# Autodesk Inventor assembly: robotfish_new_1
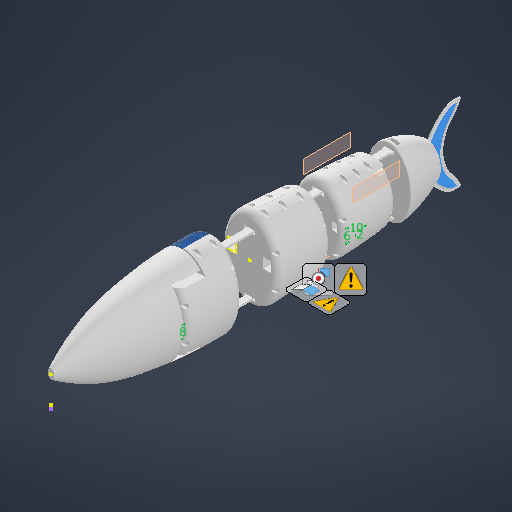
[picture p0: Inventor's stored thumbnail of the model, 512x512]
Saved by Autodesk Inventor 2027 (Build 310192060, 192F)
## iProperties
Created: 2026-08-24
Part Number: robotfish_new_1
Document SubType Name: Assembly
Designer: thita
Sending System: Autodesk Inventor 2027
Preprocessor: ST-DEVELOPER v20.1
Title: robotfish_newest_1.stp
Author: thita
## Documents named in this file (21)
- D:\Year2\đồ án tốt nghịp\đồ án tốt nghiệp v2\mới nhất v4\robotfish_final\Workgroups\NotInProject\robotfish_newest_1.iam
- D:\Year2\đồ án tốt nghịp\đồ án tốt nghiệp v2\mới nhất v4\robotfish_final\Workgroups\NotInProject\thanh lk.ipt
- D:\Year2\đồ án tốt nghịp\đồ án tốt nghiệp v2\mới nhất v4\robotfish_final\Workgroups\NotInProject\thanh lk 1.ipt
- D:\Year2\đồ án tốt nghịp\đồ án tốt nghiệp v2\mới nhất v4\robotfish_final\Workgroups\NotInProject\manh_tren_truc_2.ipt
- D:\Year2\đồ án tốt nghịp\đồ án tốt nghiệp v2\mới nhất v4\robotfish_final\Workgroups\NotInProject\manh_tren_truc_3.ipt
- D:\Year2\đồ án tốt nghịp\đồ án tốt nghiệp v2\mới nhất v4\robotfish_final\Workgroups\NotInProject\head.ipt
- D:\Year2\đồ án tốt nghịp\đồ án tốt nghiệp v2\mới nhất v4\robotfish_final\Workgroups\NotInProject\truc_khop_3_MIR.ipt
- D:\Year2\đồ án tốt nghịp\đồ án tốt nghiệp v2\mới nhất v4\robotfish_final\Workgroups\NotInProject\hop v3.iam
- D:\Year2\đồ án tốt nghịp\đồ án tốt nghiệp v2\mới nhất v4\robotfish_final\Workgroups\NotInProject\Assembly1.iam
- D:\Year2\đồ án tốt nghịp\đồ án tốt nghiệp v2\mới nhất v4\robotfish_final\Workgroups\NotInProject\thanh lk 2.ipt
- D:\Year2\đồ án tốt nghịp\đồ án tốt nghiệp v2\mới nhất v4\robotfish_final\Workgroups\NotInProject\thanh lk 4.ipt
- D:\Year2\đồ án tốt nghịp\đồ án tốt nghiệp v2\mới nhất v4\robotfish_final\Workgroups\NotInProject\thanhlk 3.ipt
- D:\Year2\đồ án tốt nghịp\đồ án tốt nghiệp v2\mới nhất v4\robotfish_final\Workgroups\NotInProject\segment2.ipt
- D:\Year2\đồ án tốt nghịp\đồ án tốt nghiệp v2\mới nhất v4\robotfish_final\Workgroups\NotInProject\thanhlk 5.ipt
- D:\Year2\đồ án tốt nghịp\đồ án tốt nghiệp v2\mới nhất v4\robotfish_final\Workgroups\NotInProject\vây đuôi phương án A.ipt
- D:\Year2\đồ án tốt nghịp\đồ án tốt nghiệp v2\mới nhất v4\robotfish_final\Workgroups\NotInProject\rigid_tailtail.ipt
- D:\Year2\đồ án tốt nghịp\đồ án tốt nghiệp v2\mới nhất v4\robotfish_final\Workgroups\NotInProject\segment1.ipt
- D:\Year2\đồ án tốt nghịp\đồ án tốt nghiệp v2\mới nhất v4\robotfish_final\Workgroups\NotInProject\segment1_left.ipt
- D:\Year2\đồ án tốt nghịp\đồ án tốt nghiệp v2\mới nhất v4\robotfish_final\Workgroups\NotInProject\segment2_left.ipt
- D:\Year2\đồ án tốt nghịp\đồ án tốt nghiệp v2\mới nhất v3\segment3.ipt
- D:\Year2\đồ án tốt nghịp\đồ án tốt nghiệp v2\mới nhất v3\segment3_MIR.ipt
## Components (21 placed, 20 different names)
1. thanh lk:1 — Mate:30
2. thanh lk 1:1 — Mate:5, Mate:6, Mate:7, Mate:8
3. manh_tren_truc_2:1
4. manh_tren_truc_3:1
5. head:1
6. truc_khop_3_MIR:1
7. hop v3:13 [sub-assembly] — Rigid:5, Mate:5, Mate:30
8. hop v3:14 [sub-assembly] — Mate:6, Mate:7, Mate:8, Mate:12, Mate:13, Mate:15, Flush:1, Mate:16, Mate:17, Mate:18
9. Assembly1:17 [sub-assembly] — Rigid:1
10. thanh lk 2:1 — Flush:1, Mate:16, Mate:17, Mate:18, Mate:19, Mate:20, Mate:23, Mate:24
11. thanh lk 4:2 — Rotational:1, Mate:31
12. thanhlk 3:2 — Mate:28, Mate:29, Mate:32
13. segment2:1 — Rotational:1, Mate:28, Mate:29, Mate:31
14. thanhlk 5:2 — Mate:21, Mate:22
15. vây đuôi phương án A:2 — Mate:25, Mate:26, Mate:27
16. rigid_tailtail:3 — Mate:19, Mate:20, Mate:21, Mate:22, Mate:23, Mate:24, Mate:25, Mate:26, Mate:27
17. segment1:2 — Rigid:1, Rigid:2, Mate:32
18. segment1_left:1 — Rigid:2
19. segment2_left:1 — Rigid:5
20. segment3:4 — Mate:12, Mate:13, Mate:15
21. segment3_MIR:1
## Relationships (29: Mate 24, WeldJoint 3, RevoluteJoint 1, Flush 1)
- Rigid:1 [WeldJoint]: Assembly1:17 ↔ segment1:2
- Rigid:2 [WeldJoint]: segment1:2 ↔ segment1_left:1
- Rigid:5 [WeldJoint]: hop v3:13 ↔ segment2_left:1
- Rotational:1 [RevoluteJoint]: thanh lk 4:2 ↔ segment2:1
- Mate:5 (0.04 mm): thanh lk 1:1 ↔ hop v3:13
- Mate:6: thanh lk 1:1 ↔ hop v3:14
- Mate:7: thanh lk 1:1 ↔ hop v3:14
- Mate:8: thanh lk 1:1 ↔ hop v3:14
- Mate:12: hop v3:14 ↔ segment3:4
- Mate:13: hop v3:14 ↔ segment3:4
- Mate:15: hop v3:14 ↔ segment3:4
- Flush:1 (-0.04 mm): hop v3:14 ↔ thanh lk 2:1
- Mate:16 (0.04 mm): hop v3:14 ↔ thanh lk 2:1
- Mate:17 (0.04 mm): hop v3:14 ↔ thanh lk 2:1
- Mate:18: hop v3:14 ↔ thanh lk 2:1
- Mate:19: thanh lk 2:1 ↔ rigid_tailtail:3
- Mate:20: thanh lk 2:1 ↔ rigid_tailtail:3
- Mate:21: thanhlk 5:2 ↔ rigid_tailtail:3
- Mate:22: thanhlk 5:2 ↔ rigid_tailtail:3
- Mate:23: thanh lk 2:1 ↔ rigid_tailtail:3
- Mate:24: thanh lk 2:1 ↔ rigid_tailtail:3
- Mate:25: vây đuôi phương án A:2 ↔ rigid_tailtail:3
- Mate:26: vây đuôi phương án A:2 ↔ rigid_tailtail:3
- Mate:27: vây đuôi phương án A:2 ↔ rigid_tailtail:3
- Mate:28: thanhlk 3:2 ↔ segment2:1
- Mate:29: thanhlk 3:2 ↔ segment2:1
- Mate:30: thanh lk:1 ↔ hop v3:13
- Mate:31: thanh lk 4:2 ↔ segment2:1
- Mate:32: thanhlk 3:2 ↔ segment1:2
## Named parameters: Finish1_Area = 450.784
note: some values were not read from the file. Shown as the stored number, unit unknown: "Finish1_Area".
